# Autodesk Inventor assembly: MM0937AN200_G03_820
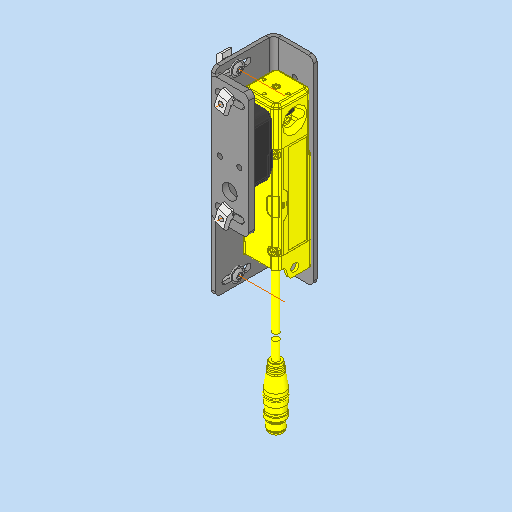
[picture p0: Inventor's stored thumbnail of the model, 512x512]
Saved by Autodesk Inventor 2023.3 (Build 273359000, 359)
## iProperties
RuleStatus: InUse
Created: 2023-03-22
Part Number: MM0937AN200_G03_820
Description: =<RBPARTNOTITLE2>
Document SubType Name: Assembly
Designer: ric7an
Mass: 520.614 g
Surface Area: 663.601 cm^2
Volume: 151.519 cm^3
Density: 3.43595 g/cm^3
AnP_Material: =<Material>
AnP_TemplVers: 20200821
RBDOCUMENTTYPE: DRF
RBDOCUMENTVERSION: 00
RBDRAWINGMAINSCALE: 1:1
RBDRAWINGMISSINGSPEC: --
RBDRAWINGVOLUME: --
RBDSV1: 0850
RBGBEDGESIN1: +0,5
RBGBEDGESIN2: +0,2
RBGBEDGESOUT1: -0,3
RBGBEDGESOUT2: -0,1
RBMATERIAL: =<Material>
RBMATMEETS: --
RBMATNO: =<Part Number>
RBPARTMADEOF: --
RBPARTNO: SIEHE MNR
RBPARTNOTITLE1: --
RBPARTSAFETYINDICATOR: --
RBSURFACE: --
RBSURFACE2: --
RBZEDGESNORM: ISO13715:2002-06
RBZGENDIMCLASS: m
RBZGENDIMNORM: ISO 2768-1:1989-11
RBZGENGEOCLASS: H
RBZGENGEONORM: ISO 2768-2:1989-11
RBZSURFACENORM: ISO13D2:2002-02
RBZTOLERANCENORM: ISO 14405-1:2010-12
Author: ric7an
Keywords: =<RBPARTMADEOF>
Comments: =<RBSURFACE2>
Revision Number: 01
## Documents named in this file (9)
- C:\Users\rea9an\Documents\Inventor\TCAI2412_te1910_EM\AS00000920.iam
- C:\Users\rea9an\Documents\Inventor\TCAI2412_te1910_EM\PT00004570.ipt
- C:\Users\rea9an\Documents\Inventor\TCAI2412_te1910_EM\PT00004396.ipt
- C:\Users\rea9an\Documents\Inventor\TCAI2412_te1910_EM\PT00004399.ipt
- C:\Users\rea9an\Documents\Inventor\TCAI2412_te1910_EM\PT00004289.ipt
- C:\Users\rea9an\Documents\Inventor\TCAI2412_te1910_EM\PT00004390.ipt
- C:\Users\rea9an\Documents\Inventor\TCAI2412_te1910_EM\PT00004566.ipt
- C:\Users\rea9an\Documents\Inventor\TCAI2412_te1910_EM\PT00004407.ipt
- C:\Users\rea9an\Documents\Inventor\TCAI2412_te1910_EM\PT00004409.ipt
## Components (15 placed, 8 different names)
1. PT00004566:1 — Passend:17
2. PT00004570:1 — Passend:18, Passend:19, Passend:20, Passend:21
3. PT00004396:1 — Einfügen:7, Einfügen:8, Einfügen:9, Passend:17
4. PT00004399:1
5. PT00004289:1
6. PT00004289:2
7. PT00004390:1
8. PT00004390:2
9. PT00004289:3
10. PT00004390:3 — Passend:18, Passend:19
11. PT00004289:4
12. PT00004390:4 — Passend:20, Passend:21
13. PT00004407:1 — Einfügen:7
14. PT00004409:1 — Einfügen:8
15. PT00004409:2 — Einfügen:9
## Relationships (30: Mate 19, Insert 5, Flush 5, Angle 1)
- [Insert]: PT00004570:1 ↔ PT00004399:1
- [Mate]: PT00004570:1 ↔ PT00004399:1
- [Mate]: PT00004396:1 ↔ PT00004399:1
- [Mate]: PT00004396:1 ↔ PT00004399:1
- [Mate]: PT00004566:1 ↔ PT00004396:1
- [Angle] (0 deg): PT00004570:1 ↔ PT00004396:1
- [Flush] (-52.5 mm): PT00004566:1 ↔ PT00004570:1
- [Mate]: PT00004289:1 ↔ PT00004390:2
- [Flush] (-0.2 mm): PT00004289:1 ↔ PT00004390:2
- [Mate]: PT00004289:2 ↔ PT00004390:1
- [Flush] (-0.2 mm): PT00004289:2 ↔ PT00004390:1
- [Mate]: PT00004566:1 ↔ PT00004390:1
- [Mate]: PT00004566:1 ↔ PT00004390:1
- [Mate]: PT00004566:1 ↔ PT00004390:2
- [Mate]: PT00004566:1 ↔ PT00004390:2
- [Insert]: PT00004566:1 ↔ PT00004396:1
- [Mate]: PT00004289:3 ↔ PT00004390:3
- [Flush] (-0.2 mm): PT00004289:3 ↔ PT00004390:3
- [Mate]: PT00004570:1 ↔ PT00004390:3
- [Mate]: PT00004289:4 ↔ PT00004390:4
- [Flush] (-0.2 mm): PT00004289:4 ↔ PT00004390:4
- [Mate]: PT00004570:1 ↔ PT00004390:4
- Einfügen:7 [Insert]: PT00004396:1 ↔ PT00004407:1
- Einfügen:8 [Insert]: PT00004396:1 ↔ PT00004409:1
- Einfügen:9 [Insert]: PT00004396:1 ↔ PT00004409:2
- Passend:17 [Mate]: PT00004566:1 ↔ PT00004396:1
- Passend:18 [Mate] (-15 mm): PT00004570:1 ↔ PT00004390:3
- Passend:19 [Mate] (-10 mm): PT00004570:1 ↔ PT00004390:3
- Passend:20 [Mate] (-15 mm): PT00004570:1 ↔ PT00004390:4
- Passend:21 [Mate] (-10 mm): PT00004570:1 ↔ PT00004390:4
## Named parameters: d318_d304_d185 = 0 mm, d319_d305_d186 = -0.2 mm, d322_d304_d185 = 0 mm, d323_d305_d186 = -0.2 mm, d304_d185 = 0 mm, d305_d186 = -0.2 mm, d306_d185 = 0 mm, d307_d186 = -0.2 mm, d292_d192 = 0 mm, d294_d163 = 0 mm, d295_d164 = 0 mm
